# Autodesk Inventor assembly: ensamble4
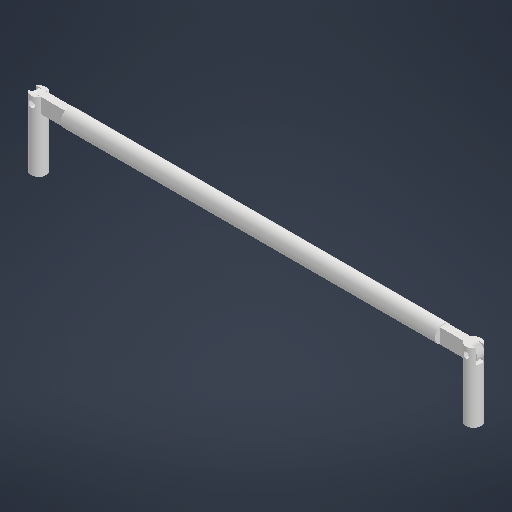
[picture p0: Inventor's stored thumbnail of the model, 512x512]
Saved by Autodesk Inventor 2027.1 (Build 311270010, 270A)
## iProperties
Created: 2026-11-07
Part Number: ensamble4
Document SubType Name: Assembly
Designer: MANGEL
Author: MANGEL
## Documents named in this file (3)
- C:\Users\MANGEL\Desktop\Brazo 4GL\ensamble4.iam
- C:\Users\MANGEL\Desktop\Brazo 4GL\barillaBrazo.ipt
- C:\Users\MANGEL\Desktop\Brazo 4GL\soporteRodillo.ipt
## Components (3 placed, 2 different names)
1. barillaBrazo:1 — Insertar:1, Insertar:2
2. soporteRodillo:1 — Insertar:1
3. soporteRodillo:2 — Insertar:2
## Relationships (2: Insert 2)
- Insertar:1: barillaBrazo:1 ↔ soporteRodillo:1
- Insertar:2: barillaBrazo:1 ↔ soporteRodillo:2
